# Autodesk Inventor assembly: gate_and-a
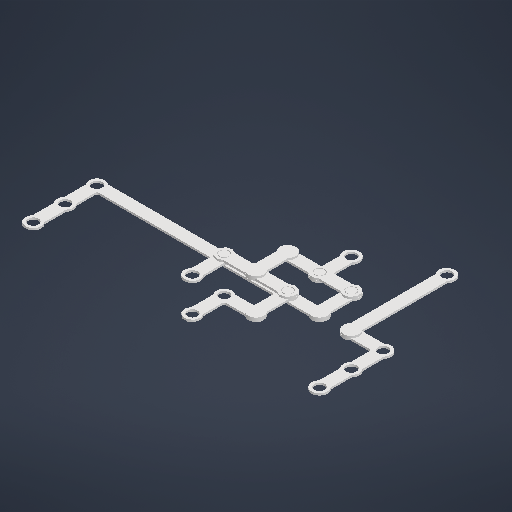
[picture p0: Inventor's stored thumbnail of the model, 512x512]
Saved by Autodesk Inventor 2025.4 (Build 294407000, 407)
## iProperties
Created: 2026-10-11
Part Number: gate_and-a
Document SubType Name: Assembly
Designer: User
Author: User
## Documents named in this file (14)
- G:\projects\primary\mechanical-computer\mechanics\gates\gate_and-a.iam
- G:\projects\primary\mechanical-computer\mechanics\links\link-1-turn-rigid.ipt
- G:\projects\primary\mechanical-computer\mechanics\links\link-1-turn-rigid\link-1-turn-rigid-7(_AS)8w-8l.ipt
- G:\projects\primary\mechanical-computer\mechanics\links\link.ipt
- G:\projects\primary\mechanical-computer\mechanics\links\link-split\link-split-8ab.ipt
- G:\projects\primary\mechanical-computer\mechanics\links\link-split.ipt
- G:\projects\primary\mechanical-computer\mechanics\links\link-1-turn\link-1-turn-8.ipt
- G:\projects\primary\mechanical-computer\mechanics\links\link-1-turn.ipt
- G:\projects\primary\mechanical-computer\mechanics\links\link\link-8-1pin.ipt
- G:\projects\primary\mechanical-computer\mechanics\links\link\link-8-2pin.ipt
- G:\projects\primary\mechanical-computer\mechanics\links\link-1-turn-rigid\link-1-turn-rigid-8.ipt
- G:\projects\primary\mechanical-computer\mechanics\links\link\link-8(_AS)3-1pin.ipt
- G:\projects\primary\mechanical-computer\mechanics\links\link\link-8-2pin-same.ipt
- G:\projects\primary\mechanical-computer\mechanics\gates\decoder.iam
## Components (12 placed, 9 different names)
1. link-1-turn-rigid-7(_AS)8w-8l:1 — Mate:7, Cylindrical:20, Mate:17, Mate:18, Angle:2
2. link-8-1pin:1 — Mate:1, Cylindrical:11, Mate:16
3. link-8-2pin:2 — Mate:6, Mate:7, Cylindrical:19, Cylindrical:20, Angle:2
4. link-8-2pin-same:3 — Mate:10, Cylindrical:21, Cylindrical:22, Mate:12
5. link-8-2pin:4 — Mate:2, Cylindrical:17, Cylindrical:18, Angle:1
6. link-split-8ab:1 — Mate:1, Mate:2, Cylindrical:11, Cylindrical:17, Cylindrical:22, Mate:12
7. link-split-8ab:2 — Mate:6, Mate:8, Cylindrical:14, Cylindrical:19, Mate:10, Cylindrical:21, Angle:3
8. link-1-turn-8:1 — Cylindrical:18, Mate:13, Mate:14, Mate:15, Angle:1
9. link-1-turn-rigid-8:3 — Mate:9, Cylindrical:23, Mate:11, Mate:19, Mate:20, Angle:4
10. link-8-1pin:5 — Mate:8, Cylindrical:14, Angle:3
11. link-8(_AS)3-1pin:6 — Mate:9, Cylindrical:23, Angle:4
12. decoder:1 [sub-assembly] — Mate:11, Mate:13, Mate:14, Mate:15, Mate:16, Mate:17, Mate:18, Mate:19, Mate:20
## Relationships (31: Mate 18, CylindricalJoint 9, Angle 4)
- Mate:1: link-8-1pin:1 ↔ link-split-8ab:1
- Mate:2: link-8-2pin:4 ↔ link-split-8ab:1
- [Mate]: link-8-2pin:4 ↔ link-1-turn-8:1
- Mate:6: link-8-2pin:2 ↔ link-split-8ab:2
- Mate:7: link-1-turn-rigid-7(_AS)8w-8l:1 ↔ link-8-2pin:2
- Mate:8: link-split-8ab:2 ↔ link-8-1pin:5
- Mate:9: link-1-turn-rigid-8:3 ↔ link-8(_AS)3-1pin:6
- Cylindrical:11: link-8-1pin:1 ↔ link-split-8ab:1
- Cylindrical:14: link-split-8ab:2 ↔ link-8-1pin:5
- Cylindrical:17: link-8-2pin:4 ↔ link-split-8ab:1
- Cylindrical:18: link-8-2pin:4 ↔ link-1-turn-8:1
- Cylindrical:19: link-8-2pin:2 ↔ link-split-8ab:2
- Cylindrical:20: link-1-turn-rigid-7(_AS)8w-8l:1 ↔ link-8-2pin:2
- Mate:10: link-8-2pin-same:3 ↔ link-split-8ab:2
- Cylindrical:21: link-8-2pin-same:3 ↔ link-split-8ab:2
- Cylindrical:22: link-8-2pin-same:3 ↔ link-split-8ab:1
- Cylindrical:23: link-1-turn-rigid-8:3 ↔ link-8(_AS)3-1pin:6
- Mate:11: link-1-turn-rigid-8:3 ↔ decoder:1
- Mate:12: link-8-2pin-same:3 ↔ link-split-8ab:1
- Mate:13: link-1-turn-8:1 ↔ decoder:1
- Mate:14: link-1-turn-8:1 ↔ decoder:1
- Mate:15: link-1-turn-8:1 ↔ decoder:1
- Mate:16: link-8-1pin:1 ↔ decoder:1
- Mate:17: link-1-turn-rigid-7(_AS)8w-8l:1 ↔ decoder:1
- Mate:18: link-1-turn-rigid-7(_AS)8w-8l:1 ↔ decoder:1
- Mate:19: link-1-turn-rigid-8:3 ↔ decoder:1
- Mate:20: link-1-turn-rigid-8:3 ↔ decoder:1
- Angle:1 (90 deg): link-8-2pin:4 ↔ link-1-turn-8:1
- Angle:2 (90 deg): link-1-turn-rigid-7(_AS)8w-8l:1 ↔ link-8-2pin:2
- Angle:3 (90 deg): link-split-8ab:2 ↔ link-8-1pin:5
- Angle:4 (90 deg): link-1-turn-rigid-8:3 ↔ link-8(_AS)3-1pin:6
